# Autodesk Inventor assembly: MM0937AN200_G03_819
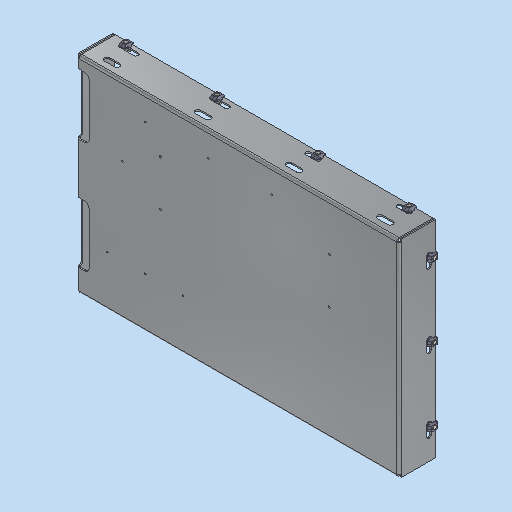
[picture p0: Inventor's stored thumbnail of the model, 512x512]
Saved by Autodesk Inventor 2023.3 (Build 273359000, 359)
## iProperties
RuleStatus: InUse
Created: 2023-03-22
Part Number: MM0937AN200_G03_819
Description: =<RBPARTNOTITLE2>
Document SubType Name: Assembly
Designer: ric7an
Mass: 2818.31 g
Surface Area: 8100.05 cm^2
Volume: 996.486 cm^3
Density: 2.82825 g/cm^3
AnP_Material: =<Material>
AnP_TemplVers: 20200821
RBDOCUMENTTYPE: DRF
RBDOCUMENTVERSION: 00
RBDRAWINGMAINSCALE: 1:1
RBDRAWINGMISSINGSPEC: --
RBDRAWINGVOLUME: --
RBDSV1: 0850
RBGBEDGESIN1: +0,5
RBGBEDGESIN2: +0,2
RBGBEDGESOUT1: -0,3
RBGBEDGESOUT2: -0,1
RBMATERIAL: =<Material>
RBMATMEETS: --
RBMATNO: =<Part Number>
RBPARTMADEOF: --
RBPARTNO: SIEHE MNR
RBPARTNOTITLE1: --
RBPARTSAFETYINDICATOR: --
RBSURFACE: --
RBSURFACE2: --
RBZEDGESNORM: ISO13715:2002-06
RBZGENDIMCLASS: m
RBZGENDIMNORM: ISO 2768-1:1989-11
RBZGENGEOCLASS: H
RBZGENGEONORM: ISO 2768-2:1989-11
RBZSURFACENORM: ISO13D2:2002-02
RBZTOLERANCENORM: ISO 14405-1:2010-12
Author: ric7an
Keywords: =<RBPARTMADEOF>
Comments: =<RBSURFACE2>
Revision Number: 01
## Documents named in this file (4)
- C:\Users\rea9an\Documents\Inventor\TCAI2412_te1910_EM\AS00000919.iam
- C:\Users\rea9an\Documents\Inventor\TCAI2412_te1910_EM\PT00004807.ipt
- C:\Users\rea9an\Documents\Inventor\TCAI2412_te1910_EM\PT00004480.ipt
- C:\Users\rea9an\Documents\Inventor\TCAI2412_te1910_EM\PT00004311.ipt
## Components (29 placed, 3 different names)
1. PT00004807:1
2. PT00004480:1
3. PT00004311:1
4. PT00004480:2
5. PT00004311:2
6. PT00004480:3
7. PT00004311:3
8. PT00004480:4
9. PT00004311:4
10. PT00004480:5
11. PT00004311:5
12. PT00004480:6
13. PT00004311:6
14. PT00004480:7
15. PT00004311:7
16. PT00004480:8
17. PT00004311:8
18. PT00004480:9
19. PT00004311:9
20. PT00004480:10
21. PT00004311:10
22. PT00004480:11
23. PT00004311:11
24. PT00004480:12
25. PT00004311:12
26. PT00004480:13
27. PT00004311:13
28. PT00004480:14
29. PT00004311:14
## Relationships (28: Insert 28)
- [Insert] (5 mm): PT00004480:1 ↔ PT00004311:1
- [Insert]: PT00004807:1 ↔ PT00004480:1
- [Insert] (5 mm): PT00004480:2 ↔ PT00004311:2
- [Insert] (5 mm): PT00004480:3 ↔ PT00004311:3
- [Insert] (5 mm): PT00004480:4 ↔ PT00004311:4
- [Insert] (5 mm): PT00004480:5 ↔ PT00004311:5
- [Insert] (5 mm): PT00004480:6 ↔ PT00004311:6
- [Insert] (5 mm): PT00004480:7 ↔ PT00004311:7
- [Insert]: PT00004807:1 ↔ PT00004480:7
- [Insert]: PT00004807:1 ↔ PT00004480:2
- [Insert]: PT00004807:1 ↔ PT00004480:4
- [Insert]: PT00004807:1 ↔ PT00004480:3
- [Insert]: PT00004807:1 ↔ PT00004480:5
- [Insert] (5 mm): PT00004480:8 ↔ PT00004311:8
- [Insert] (5 mm): PT00004480:9 ↔ PT00004311:9
- [Insert] (5 mm): PT00004480:10 ↔ PT00004311:10
- [Insert] (5 mm): PT00004480:11 ↔ PT00004311:11
- [Insert] (5 mm): PT00004480:12 ↔ PT00004311:12
- [Insert] (5 mm): PT00004480:13 ↔ PT00004311:13
- [Insert]: PT00004807:1 ↔ PT00004480:6
- [Insert]: PT00004807:1 ↔ PT00004480:8
- [Insert]: PT00004807:1 ↔ PT00004480:9
- [Insert]: PT00004807:1 ↔ PT00004480:10
- [Insert]: PT00004807:1 ↔ PT00004480:11
- [Insert]: PT00004807:1 ↔ PT00004480:12
- [Insert]: PT00004807:1 ↔ PT00004480:13
- [Insert] (5 mm): PT00004480:14 ↔ PT00004311:14
- [Insert]: PT00004807:1 ↔ PT00004480:14
## Named parameters: d177_d177_d34_d725_d707 = 5 mm, d164_d177_d34_d725_d707 = 5 mm, d165_d177_d34_d725_d707 = 5 mm, d166_d177_d34_d725_d707 = 5 mm, d167_d177_d34_d725_d707 = 5 mm, d168_d177_d34_d725_d707 = 5 mm, d169_d177_d34_d725_d707 = 5 mm, d177_d34_d725_d707 = 5 mm, d150_d177_d34_d725_d707 = 5 mm, d151_d177_d34_d725_d707 = 5 mm, d152_d177_d34_d725_d707 = 5 mm, d153_d177_d34_d725_d707 = 5 mm, d154_d177_d34_d725_d707 = 5 mm, d155_d177_d34_d725_d707 = 5 mm
